# Autodesk Inventor assembly: MontagemCASE
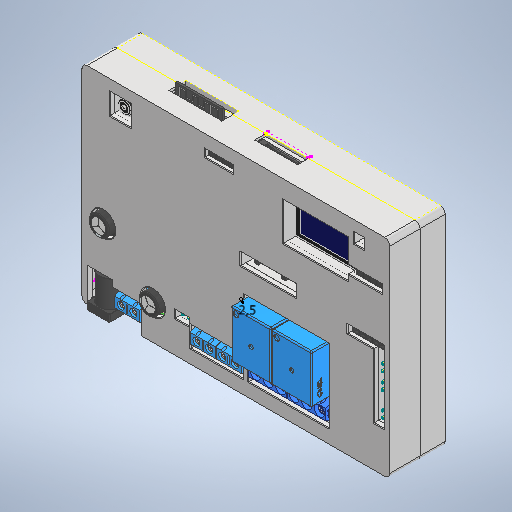
[picture p0: Inventor's stored thumbnail of the model, 512x512]
Saved by Autodesk Inventor 2026.3 (Build 303398000, 398)
## iProperties
Created: 2026-05-25
Part Number: MontagemCASE
Document SubType Name: Assembly
Designer: franciscowilke
Author: franciscowilke
## Documents named in this file (4)
- C:\Users\franciscowilke\Desktop\CASE_KIIRA\COMPONENTES CAIXA v3\MontagemCASE.iam
- C:\Users\franciscowilke\Desktop\CASE_KIIRA\3D_PCB2_2026-05-22.iam
- C:\Users\franciscowilke\Desktop\CASE_KIIRA\COMPONENTES CAIXA v3\2_caixa_KiiRA_v2.ipt
- C:\Users\franciscowilke\Desktop\CASE_KIIRA\COMPONENTES CAIXA v3\3_tampa_KiiRA_v2.ipt
## Components (3 placed, 3 different names)
1. 3D_PCB2_2026-05-22:1 [sub-assembly] — Coincidente:1
2. 2_caixa_KiiRA_v2:1 — Coincidente:1, Coincidente:2, Coincidente:3
3. 3_tampa_KiiRA_v2:1 — Coincidente:2, Coincidente:3
## Relationships (3: Mate 3)
- Coincidente:1 [Mate]: 3D_PCB2_2026-05-22:1 ↔ 2_caixa_KiiRA_v2:1
- Coincidente:2 [Mate]: 2_caixa_KiiRA_v2:1 ↔ 3_tampa_KiiRA_v2:1
- Coincidente:3 [Mate]: 2_caixa_KiiRA_v2:1 ↔ 3_tampa_KiiRA_v2:1
